# Autodesk Inventor assembly: Stabilsateur1_2
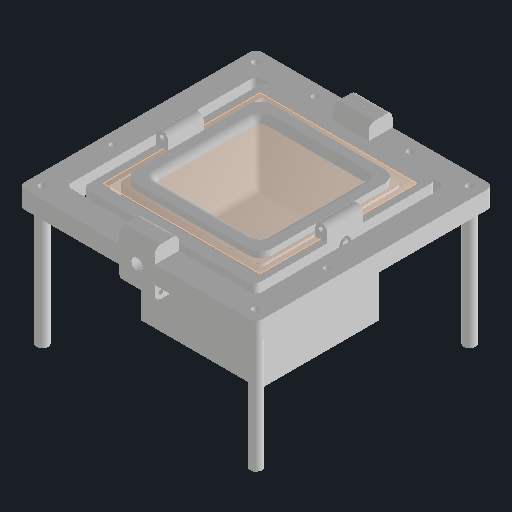
[picture p0: Inventor's stored thumbnail of the model, 512x512]
Saved by Autodesk Inventor 2026 (Build 300175000, 175)
## iProperties
Created: 2025-05-01
Part Number: Stabilsateur1_2
Document SubType Name: Assembly
Designer: karle
Author: karle
## Documents named in this file (7)
- C:\Users\remg9\OneDrive - HESSO\P2511_Dossier_partage_RVEZ\01_Robot\0101_CAO\2_Stabil\Stabilsateur1_2.iam
- C:\Users\remg9\OneDrive - HESSO\P2511_Dossier_partage_RVEZ\01_Robot\0101_CAO\2_Stabil\2_01_stabilisateur_intérieur.ipt
- C:\Users\karle\Documents\Inventor\Content Center Files\R2025\de-DE\KS B 2023\KS B 2023 - 685 - 5 x 11 x 3 - 0.458.ipt
- C:\Users\remg9\OneDrive - HESSO\P2511_Dossier_partage_RVEZ\01_Robot\0101_CAO\2_Stabil\2_02_stabilisatuer_milieu.ipt
- C:\Users\remg9\OneDrive - HESSO\P2511_Dossier_partage_RVEZ\01_Robot\0101_CAO\2_Stabil\2_03_stabilisatuer_extérieur.ipt
- C:\Users\remg9\OneDrive - HESSO\P2511_Dossier_partage_RVEZ\01_Robot\0101_CAO\2_Stabil\2_04_stabilisatuer_supports.ipt
- C:\Users\remg9\OneDrive - HESSO\P2511_Dossier_partage_RVEZ\01_Robot\0101_CAO\2_Stabil\2_05_recipien_eau.ipt
## Components (16 placed, 6 different names)
1. 2_01_stabilisateur_intérieur:1 — Insert:1, Insert:2, Flush:1, Flush:2
2. KS B 2023 685 - 5 x 11 x 3:1 — Insert:2
3. KS B 2023 685 - 5 x 11 x 3:2 — Insert:1
4. 2_02_stabilisatuer_milieu:1 — Mate:1, Insert:3, Insert:4, Insert:5, Mate:2
5. 2_02_stabilisatuer_milieu:2 — Mate:1, Insert:3, Insert:4, Insert:7
6. KS B 2023 685 - 5 x 11 x 3:3 — Insert:5, Insert:6, Insert:9
7. KS B 2023 685 - 5 x 11 x 3:4 — Insert:6
8. KS B 2023 685 - 5 x 11 x 3:5 — Insert:7, Insert:8
9. KS B 2023 685 - 5 x 11 x 3:6 — Insert:8
10. 2_03_stabilisatuer_extérieur:1 — Insert:9, Insert:10, Insert:11, Insert:12, Mate:2, Insert:13, Insert:16
11. 2_03_stabilisatuer_extérieur:2 — Insert:10, Insert:11, Insert:12, Insert:14, Insert:15
12. 2_04_stabilisatuer_supports:1 — Insert:13
13. 2_04_stabilisatuer_supports:2 — Insert:14
14. 2_04_stabilisatuer_supports:3 — Insert:15
15. 2_04_stabilisatuer_supports:4 — Insert:16
16. 2_05_recipien_eau:1 — Flush:1, Flush:2
## Relationships (20: Insert 16, Mate 2, Flush 2)
- Insert:1: 2_01_stabilisateur_intérieur:1 ↔ KS B 2023 685 - 5 x 11 x 3:2
- Insert:2: 2_01_stabilisateur_intérieur:1 ↔ KS B 2023 685 - 5 x 11 x 3:1
- Mate:1: 2_02_stabilisatuer_milieu:1 ↔ 2_02_stabilisatuer_milieu:2
- Insert:3: 2_02_stabilisatuer_milieu:1 ↔ 2_02_stabilisatuer_milieu:2
- Insert:4: 2_02_stabilisatuer_milieu:1 ↔ 2_02_stabilisatuer_milieu:2
- Insert:5: 2_02_stabilisatuer_milieu:1 ↔ KS B 2023 685 - 5 x 11 x 3:3
- Insert:6: KS B 2023 685 - 5 x 11 x 3:3 ↔ KS B 2023 685 - 5 x 11 x 3:4
- Insert:7: 2_02_stabilisatuer_milieu:2 ↔ KS B 2023 685 - 5 x 11 x 3:5
- Insert:8: KS B 2023 685 - 5 x 11 x 3:5 ↔ KS B 2023 685 - 5 x 11 x 3:6
- Insert:9: KS B 2023 685 - 5 x 11 x 3:3 ↔ 2_03_stabilisatuer_extérieur:1
- Insert:10: 2_03_stabilisatuer_extérieur:1 ↔ 2_03_stabilisatuer_extérieur:2
- Insert:11: 2_03_stabilisatuer_extérieur:1 ↔ 2_03_stabilisatuer_extérieur:2
- Insert:12: 2_03_stabilisatuer_extérieur:1 ↔ 2_03_stabilisatuer_extérieur:2
- Mate:2: 2_02_stabilisatuer_milieu:1 ↔ 2_03_stabilisatuer_extérieur:1
- Insert:13: 2_03_stabilisatuer_extérieur:1 ↔ 2_04_stabilisatuer_supports:1
- Insert:14: 2_03_stabilisatuer_extérieur:2 ↔ 2_04_stabilisatuer_supports:2
- Insert:15: 2_03_stabilisatuer_extérieur:2 ↔ 2_04_stabilisatuer_supports:3
- Insert:16: 2_03_stabilisatuer_extérieur:1 ↔ 2_04_stabilisatuer_supports:4
- Flush:1: 2_01_stabilisateur_intérieur:1 ↔ 2_05_recipien_eau:1
- Flush:2: 2_01_stabilisateur_intérieur:1 ↔ 2_05_recipien_eau:1
